# Autodesk Inventor assembly: ASY DMF-4100 Motor Stand
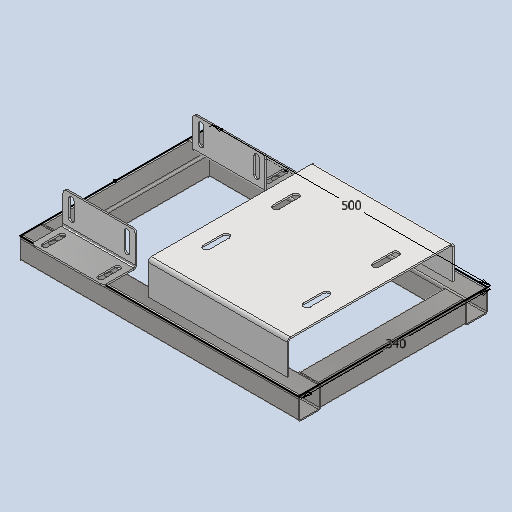
[picture p0: Inventor's stored thumbnail of the model, 512x512]
Saved by Autodesk Inventor 2026.2 (Build 302298000, 298)
## iProperties
Created: 2026-06-04
Part Number: ASY DMF-4100 Motor Stand
Document SubType Name: Assembly
Designer: admin
Stock Number: DMF-4100
_SolveAssemblyDoc: Frame Generator Solve Assembly
_Version: 25.0.0
Author: admin
## Documents named in this file (5)
- C:\Users\admin\Documents\Inventor\DMF-Disk-Micro-Filter\ASY DMF-4100 Motor Stand.iam
- C:\Users\admin\Documents\Inventor\DMF-Disk-Micro-Filter\DMF-4102 Motor Stand Sketch.ipt
- C:\Users\admin\Documents\Inventor\DMF-Disk-Micro-Filter\Подставка под мотор\Frame\Frame 1780576945572.iam
- C:\Users\admin\Documents\Inventor\DMF-Disk-Micro-Filter\DMF-4101 Gearbox Stand 01.ipt
- C:\Users\admin\Documents\Inventor\DMF-Disk-Micro-Filter\DMF-4005 Bed Bow Mount.ipt
## Components (5 placed, 4 different names)
1. DMF-4102 Motor Stand Sketch:1
2. DMF-4005 Bed Bow Mount:2 — Rigid:1
3. DMF-4005 Bed Bow Mount:1 — Rigid:2
4. DMF-4101 Gearbox Stand 01:1 — Mate:3, Mate:5, Mate:6
5. Frame 1780576945572:1 [sub-assembly] — Mate:5, Mate:6, Rigid:1, Rigid:2
## Relationships (5: Mate 3, WeldJoint 2)
- Mate:3: DMF-4101 Gearbox Stand 01:1
- Mate:5: DMF-4101 Gearbox Stand 01:1 ↔ Frame 1780576945572:1
- Mate:6: DMF-4101 Gearbox Stand 01:1 ↔ Frame 1780576945572:1
- Rigid:1 [WeldJoint]: DMF-4005 Bed Bow Mount:2 ↔ Frame 1780576945572:1
- Rigid:2 [WeldJoint]: DMF-4005 Bed Bow Mount:1 ↔ Frame 1780576945572:1
